# Autodesk Inventor assembly: assembly_sertar_inferior
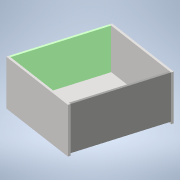
[picture p0: Inventor's stored thumbnail of the model, 180x180]
Saved by Autodesk Inventor 2022.6 (Build 266554000, 554)
## iProperties
RuleStatus: InUse
Created: 2026-10-23
Part Number: assembly_sertar_inferior
Document SubType Name: Assembly
Designer: Dragos Macovei
Author: Dragos Macovei
## Documents named in this file (5)
- C:\Users\Dragos Macovei\Documents\3D_Parts\PAT ADI\assembly_sertar_inferior.iam
- C:\Users\Dragos Macovei\Documents\3D_Parts\PAT ADI\fund_sertar.ipt
- C:\Users\Dragos Macovei\Documents\3D_Parts\PAT ADI\sertar_inferior_latime.ipt
- C:\Users\Dragos Macovei\Documents\3D_Parts\PAT ADI\sertar_inferior_latime_parte_din_spate.ipt
- C:\Users\Dragos Macovei\Documents\3D_Parts\PAT ADI\sertar_inferior_lungime.ipt
## Components (5 placed, 4 different names)
1. fund_sertar:1 — Mate:4, Mate:5, Flush:10
2. sertar_inferior_latime:1 — Mate:1, Flush:1, Flush:2, Flush:5, Mate:3, Flush:8, Mate:5, Flush:11, Flush:12
3. sertar_inferior_latime_parte_din_spate:1 — Mate:2, Flush:7, Flush:9, Flush:13, Flush:14
4. sertar_inferior_lungime:1 — Mate:1, Flush:1, Flush:2, Mate:2, Flush:9, Flush:11, Flush:14
5. sertar_inferior_lungime:2 — Flush:5, Flush:7, Mate:3, Flush:8, Mate:4, Flush:10, Flush:12, Flush:13
## Relationships (16: Flush 11, Mate 5)
- Mate:1: sertar_inferior_latime:1 ↔ sertar_inferior_lungime:1
- Flush:1: sertar_inferior_latime:1 ↔ sertar_inferior_lungime:1
- Flush:2: sertar_inferior_latime:1 ↔ sertar_inferior_lungime:1
- Flush:5: sertar_inferior_latime:1 ↔ sertar_inferior_lungime:2
- Mate:2: sertar_inferior_latime_parte_din_spate:1 ↔ sertar_inferior_lungime:1
- Flush:7: sertar_inferior_latime_parte_din_spate:1 ↔ sertar_inferior_lungime:2
- Mate:3: sertar_inferior_latime:1 ↔ sertar_inferior_lungime:2
- Flush:8: sertar_inferior_latime:1 ↔ sertar_inferior_lungime:2
- Flush:9: sertar_inferior_latime_parte_din_spate:1 ↔ sertar_inferior_lungime:1
- Mate:4: fund_sertar:1 ↔ sertar_inferior_lungime:2
- Mate:5: fund_sertar:1 ↔ sertar_inferior_latime:1
- Flush:10 (15 mm): fund_sertar:1 ↔ sertar_inferior_lungime:2
- Flush:11: sertar_inferior_latime:1 ↔ sertar_inferior_lungime:1
- Flush:12: sertar_inferior_latime:1 ↔ sertar_inferior_lungime:2
- Flush:13: sertar_inferior_latime_parte_din_spate:1 ↔ sertar_inferior_lungime:2
- Flush:14: sertar_inferior_latime_parte_din_spate:1 ↔ sertar_inferior_lungime:1
